# Autodesk Inventor assembly: Stabilsateur1_1
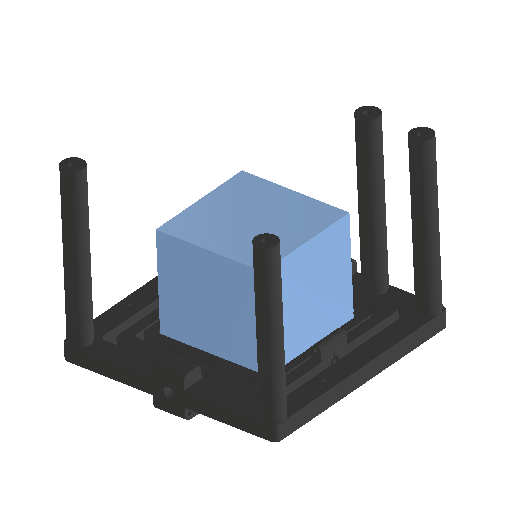
[picture p0: Inventor's stored thumbnail of the model, 512x512]
Saved by Autodesk Inventor 2026 (Build 300175000, 175)
## iProperties
Created: 2025-04-25
Part Number: Stabilsateur1_1
Document SubType Name: Assembly
Designer: karle
Author: karle
## Documents named in this file (6)
- C:\Users\remg9\OneDrive - HESSO\P2511_Dossier_partage_RVEZ\01_Robot\0101_CAO\2_Stabil\Stabilsateur1_1.iam
- C:\Users\remg9\OneDrive - HESSO\P2511_Dossier_partage_RVEZ\01_Robot\0101_CAO\2_Stabil\2_01_stabilisateur_intérieur.ipt
- C:\Users\remg9\OneDrive - HESSO\P2511_Dossier_partage_RVEZ\01_Robot\0101_CAO\2_Stabil\2_02_stabilisatuer_milieu.ipt
- C:\Users\remg9\OneDrive - HESSO\P2511_Dossier_partage_RVEZ\01_Robot\0101_CAO\2_Stabil\2_03_stabilisatuer_extérieur.ipt
- C:\Users\remg9\OneDrive - HESSO\P2511_Dossier_partage_RVEZ\01_Robot\0101_CAO\2_Stabil\2_04_stabilisatuer_supports.ipt
- C:\Users\remg9\OneDrive - HESSO\P2511_Dossier_partage_RVEZ\01_Robot\0101_CAO\2_Stabil\2_05_recipien_eau.ipt
## Components (10 placed, 5 different names)
1. 2_01_stabilisateur_intérieur:1 — Insert:20, Mate:12, Mate:13, Mate:14
2. 2_02_stabilisatuer_milieu:1 — Mate:10, Insert:19, Insert:20, Insert:25, Mate:11
3. 2_03_stabilisatuer_extérieur:1 — Mate:7, Insert:10, Insert:11, Insert:15, Insert:16, Insert:23, Insert:26, Insert:28
4. 2_03_stabilisatuer_extérieur:2 — Mate:7, Insert:10, Insert:11, Mate:11, Insert:27
5. 2_04_stabilisatuer_supports:1 — Insert:28
6. 2_04_stabilisatuer_supports:2 — Insert:27
7. 2_04_stabilisatuer_supports:3 — Insert:16, Insert:26
8. 2_04_stabilisatuer_supports:4 — Insert:15
9. 2_02_stabilisatuer_milieu:2 — Mate:10, Insert:19, Insert:23, Insert:25
10. 2_05_recipien_eau:1 — Mate:12, Mate:13, Mate:14
## Relationships (17: Insert 11, Mate 6)
- Mate:7: 2_03_stabilisatuer_extérieur:1 ↔ 2_03_stabilisatuer_extérieur:2
- Insert:10: 2_03_stabilisatuer_extérieur:1 ↔ 2_03_stabilisatuer_extérieur:2
- Insert:11: 2_03_stabilisatuer_extérieur:1 ↔ 2_03_stabilisatuer_extérieur:2
- Insert:15: 2_03_stabilisatuer_extérieur:1 ↔ 2_04_stabilisatuer_supports:4
- Insert:16: 2_03_stabilisatuer_extérieur:1 ↔ 2_04_stabilisatuer_supports:3
- Mate:10: 2_02_stabilisatuer_milieu:1 ↔ 2_02_stabilisatuer_milieu:2
- Insert:19: 2_02_stabilisatuer_milieu:1 ↔ 2_02_stabilisatuer_milieu:2
- Insert:20: 2_01_stabilisateur_intérieur:1 ↔ 2_02_stabilisatuer_milieu:1
- Insert:23: 2_03_stabilisatuer_extérieur:1 ↔ 2_02_stabilisatuer_milieu:2
- Insert:25: 2_02_stabilisatuer_milieu:1 ↔ 2_02_stabilisatuer_milieu:2
- Mate:11: 2_02_stabilisatuer_milieu:1 ↔ 2_03_stabilisatuer_extérieur:2
- Mate:12: 2_01_stabilisateur_intérieur:1 ↔ 2_05_recipien_eau:1
- Mate:13: 2_01_stabilisateur_intérieur:1 ↔ 2_05_recipien_eau:1
- Mate:14: 2_01_stabilisateur_intérieur:1 ↔ 2_05_recipien_eau:1
- Insert:26: 2_03_stabilisatuer_extérieur:1 ↔ 2_04_stabilisatuer_supports:3
- Insert:27: 2_03_stabilisatuer_extérieur:2 ↔ 2_04_stabilisatuer_supports:2
- Insert:28: 2_03_stabilisatuer_extérieur:1 ↔ 2_04_stabilisatuer_supports:1
